# Autodesk Inventor assembly: Assembly1
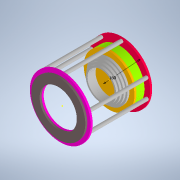
[picture p0: Inventor's stored thumbnail of the model, 180x180]
Saved by Autodesk Inventor 2022.6 (Build 266554000, 554)
## iProperties
Created: 2025-06-10
Part Number: Assembly1
Document SubType Name: Assembly
Designer: Dragos Macovei
Author: Dragos Macovei
## Documents named in this file (11)
- C:\Users\Dragos Macovei\Documents\Inventor_3d_parts\Felinar\Assembly1.iam
- C:\Users\Dragos Macovei\Documents\Inventor_3d_parts\Felinar\capac felinar_A.ipt
- C:\Users\Dragos Macovei\Documents\Inventor_3d_parts\Felinar\capac felinar_b.ipt
- C:\Users\Dragos Macovei\Documents\Inventor_3d_parts\Felinar\cep.ipt
- C:\Users\Dragos Macovei\Documents\Inventor_3d_parts\Felinar\fund felinar.ipt
- C:\Users\Dragos Macovei\Documents\Inventor_3d_parts\Felinar\inglobare_baterie.ipt
- C:\Users\Dragos Macovei\Documents\Inventor_3d_parts\Felinar\capac_baterie.ipt
- C:\Users\Dragos Macovei\Documents\Inventor_3d_parts\Felinar\suport_lumanare_2.ipt
- C:\Users\Dragos Macovei\Documents\Inventor_3d_parts\Felinar\suport_lumanare_3.ipt
- C:\Users\Dragos Macovei\Documents\Inventor_3d_parts\Felinar\suport_lumanare_4.ipt
- C:\Users\Dragos Macovei\Documents\Inventor_3d_parts\Felinar\suport_lumanare_5.ipt
## Components (17 placed, 10 different names)
1. capac felinar_A:1 — Mate:1, Mate:2, Mate:8, Tangent:6, Tangent:7, Tangent:8, Tangent:9, Tangent:10
2. capac felinar_b:1 — Mate:1, Mate:2
3. cep:1 — Mate:7, Tangent:1, Tangent:6
4. fund felinar:1 — Mate:3, Mate:4, Mate:5, Mate:6, Mate:7, Tangent:1, Tangent:2, Tangent:3, Tangent:4, Tangent:5, Mate:12
5. cep:2 — Mate:4, Tangent:3, Tangent:8
6. cep:3 — Mate:5, Tangent:2, Tangent:7, Tangent:11
7. cep:4 — Mate:3, Tangent:4, Mate:8, Tangent:9, Tangent:12
8. cep:5 — Mate:6, Tangent:5, Tangent:10
9. inglobare_baterie:1 — Mate:10, Mate:11, Flush:2, Flush:3, Flush:4, Flush:5
10. inglobare_baterie:2 — Mate:11, Flush:2, Flush:4, Tangent:11, Tangent:12, Mate:13, Insert:1
11. inglobare_baterie:3 — Flush:1, Mate:9, Mate:10, Flush:3, Flush:5, Flush:6
12. inglobare_baterie:4 — Flush:1, Mate:9, Flush:6, Mate:12
13. capac_baterie:1 — Mate:13, Insert:1, Insert:2
14. suport_lumanare_2:1 — Insert:2, Insert:3
15. suport_lumanare_3:1 — Insert:3, Insert:4
16. suport_lumanare_4:1 — Insert:4, Insert:5
17. suport_lumanare_5:1 — Insert:5
## Relationships (36: Mate 13, Tangent 12, Flush 6, Insert 5)
- Mate:1: capac felinar_A:1 ↔ capac felinar_b:1
- Mate:2: capac felinar_A:1 ↔ capac felinar_b:1
- Mate:3: fund felinar:1 ↔ cep:4
- Mate:4: fund felinar:1 ↔ cep:2
- Mate:5: fund felinar:1 ↔ cep:3
- Mate:6: fund felinar:1 ↔ cep:5
- Mate:7: cep:1 ↔ fund felinar:1
- Tangent:1: cep:1 ↔ fund felinar:1
- Tangent:2: fund felinar:1 ↔ cep:3
- Tangent:3: fund felinar:1 ↔ cep:2
- Tangent:4: fund felinar:1 ↔ cep:4
- Tangent:5: fund felinar:1 ↔ cep:5
- Mate:8: capac felinar_A:1 ↔ cep:4
- Tangent:6: capac felinar_A:1 ↔ cep:1
- Tangent:7: capac felinar_A:1 ↔ cep:3
- Tangent:8: capac felinar_A:1 ↔ cep:2
- Tangent:9: capac felinar_A:1 ↔ cep:4
- Tangent:10: capac felinar_A:1 ↔ cep:5
- Flush:1: inglobare_baterie:3 ↔ inglobare_baterie:4
- Mate:9: inglobare_baterie:3 ↔ inglobare_baterie:4
- Mate:10: inglobare_baterie:1 ↔ inglobare_baterie:3
- Mate:11: inglobare_baterie:1 ↔ inglobare_baterie:2
- Flush:2: inglobare_baterie:1 ↔ inglobare_baterie:2
- Flush:3: inglobare_baterie:1 ↔ inglobare_baterie:3
- Flush:4: inglobare_baterie:1 ↔ inglobare_baterie:2
- Flush:5: inglobare_baterie:1 ↔ inglobare_baterie:3
- Flush:6: inglobare_baterie:3 ↔ inglobare_baterie:4
- Mate:12: fund felinar:1 ↔ inglobare_baterie:4
- Tangent:11 (5 mm): cep:3 ↔ inglobare_baterie:2
- Tangent:12 (5 mm): cep:4 ↔ inglobare_baterie:2
- Mate:13: inglobare_baterie:2 ↔ capac_baterie:1
- Insert:1: inglobare_baterie:2 ↔ capac_baterie:1
- Insert:2: capac_baterie:1 ↔ suport_lumanare_2:1
- Insert:3: suport_lumanare_2:1 ↔ suport_lumanare_3:1
- Insert:4: suport_lumanare_3:1 ↔ suport_lumanare_4:1
- Insert:5: suport_lumanare_4:1 ↔ suport_lumanare_5:1
